# Autodesk Inventor assembly: Ensemble1
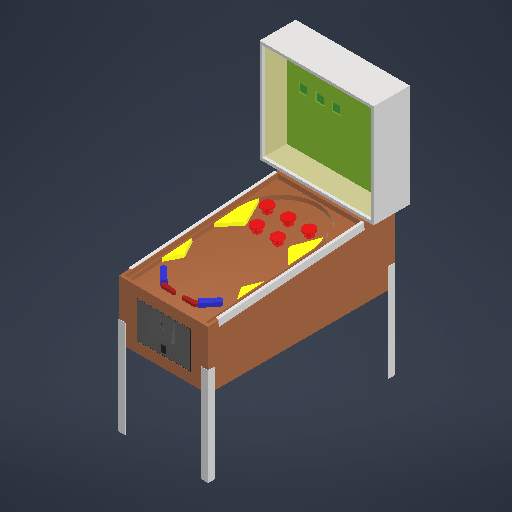
[picture p0: Inventor's stored thumbnail of the model, 512x512]
Saved by Autodesk Inventor 2027 (Build 310192060, 192F)
## iProperties
RuleStatus: InUse
Created: 2026-10-17
Part Number: Ensemble1
Document SubType Name: Assembly
Designer: strei
Author: strei
## Documents named in this file (12)
- C:\GIT\Ludum Dare 60\Assets\Models 3D\Pinball.iam
- C:\GIT\Ludum Dare 60\Assets\Models 3D\Front.ipt
- C:\GIT\Ludum Dare 60\Assets\Models 3D\Glass.ipt
- C:\GIT\Ludum Dare 60\Assets\Models 3D\Playfield.ipt
- C:\GIT\Ludum Dare 60\Assets\Models 3D\Box.ipt
- C:\GIT\Ludum Dare 60\Assets\Models 3D\Foot.ipt
- C:\GIT\Ludum Dare 60\Assets\Models 3D\Flipper.ipt
- C:\GIT\Ludum Dare 60\Assets\Models 3D\Electronic playfield.ipt
- C:\GIT\Ludum Dare 60\Assets\Models 3D\Electronic front.ipt
- C:\GIT\Ludum Dare 60\Assets\Models 3D\Bumper.ipt
- C:\GIT\Ludum Dare 60\Assets\Models 3D\side_bar.ipt
- C:\GIT\Ludum Dare 60\Assets\Models 3D\side_bumper.ipt
## Components (21 placed, 11 different names)
1. Front:1 — Placage:3, Placage:4, Affleurement:2, Placage:5, Affleurement:3, Affleurement:4, Placage:28, Placage:29, Placage:30
2. Glass:1 — Placage:3, Placage:4, Affleurement:2
3. Playfield:1 — Placage:1, Placage:2, Affleurement:1, Placage:21, Placage:22, Placage:23, Placage:24, Placage:31, Placage:32, Placage:33, Placage:34, Placage:35, Placage:36, Placage:37, Placage:38, Placage:39, Placage:40, Placage:47, Placage:48, Placage:49, Placage:51
4. Box:1 — Placage:1, Placage:2, Affleurement:1, Placage:5, Affleurement:3, Affleurement:4, Placage:6, Placage:7, Placage:8, Placage:11, Placage:12, Placage:13, Placage:14, Placage:15, Placage:16, Placage:17, Placage:18, Placage:19, Affleurement:5, Affleurement:6, Placage:25, Placage:26, Placage:27, Placage:41, Placage:42, Placage:43, Placage:44, Placage:45, Placage:46
5. Foot:1 — Placage:6, Placage:13, Placage:19, Placage:20
6. Foot:2 — Placage:7, Placage:8, Placage:14
7. Foot:3 — Placage:16, Placage:17, Placage:18
8. Foot:4 — Placage:11, Placage:12, Placage:15
9. Flipper:1 — Placage:21, Placage:23, Affleurement:7, Placage:50
10. Flipper:2 — Placage:22, Placage:24, Affleurement:7, Placage:52
11. Electronic playfield:1 — Placage:25, Placage:26, Placage:27
12. Electronic front:1 — Placage:28, Placage:29, Placage:30
13. Bumper:1 — Placage:34, Placage:39
14. Bumper:2 — Placage:35, Placage:38
15. Bumper:3 — Placage:32, Placage:36
16. Bumper:4 — Placage:33, Placage:37
17. Bumper:5 — Placage:31, Placage:40
18. side_bar:1 — Placage:41, Placage:42, Placage:45
19. side_bar:2 — Placage:43, Placage:44, Placage:46
20. side_bumper:1 — Placage:47, Placage:49, Placage:50
21. side_bumper:2 — Placage:48, Placage:51, Placage:52
## Relationships (57: Mate 50, Flush 7)
- Placage:1 [Mate]: Playfield:1 ↔ Box:1
- Placage:2 [Mate]: Playfield:1 ↔ Box:1
- Affleurement:1 [Flush] (60 mm): Playfield:1 ↔ Box:1
- Placage:3 [Mate]: Front:1 ↔ Glass:1
- Placage:4 [Mate]: Front:1 ↔ Glass:1
- Affleurement:2 [Flush] (20 mm): Front:1 ↔ Glass:1
- Placage:5 [Mate]: Front:1 ↔ Box:1
- Affleurement:3 [Flush] (-20 mm): Front:1 ↔ Box:1
- Affleurement:4 [Flush] (90 mm): Front:1 ↔ Box:1
- Placage:6 [Mate]: Box:1 ↔ Foot:1
- Placage:7 [Mate]: Box:1 ↔ Foot:2
- Placage:8 [Mate]: Box:1 ↔ Foot:2
- Placage:11 [Mate]: Box:1 ↔ Foot:4
- Placage:12 [Mate]: Box:1 ↔ Foot:4
- Placage:13 [Mate] (-150 mm): Box:1 ↔ Foot:1
- Placage:14 [Mate] (-150 mm): Box:1 ↔ Foot:2
- Placage:15 [Mate] (-150 mm): Box:1 ↔ Foot:4
- Placage:16 [Mate]: Box:1 ↔ Foot:3
- Placage:17 [Mate]: Box:1 ↔ Foot:3
- Placage:18 [Mate] (-150 mm): Box:1 ↔ Foot:3
- Placage:19 [Mate]: Box:1 ↔ Foot:1
- Placage:20 [Mate]: Foot:1
- Affleurement:5 [Flush]: Box:1
- Affleurement:6 [Flush] (-300 mm): Box:1
- Placage:21 [Mate]: Playfield:1 ↔ Flipper:1
- Placage:22 [Mate]: Playfield:1 ↔ Flipper:2
- Placage:23 [Mate]: Playfield:1 ↔ Flipper:1
- Placage:24 [Mate]: Playfield:1 ↔ Flipper:2
- Affleurement:7 [Flush]: Flipper:1 ↔ Flipper:2
- Placage:25 [Mate] (5 mm): Box:1 ↔ Electronic playfield:1
- Placage:26 [Mate] (5 mm): Box:1 ↔ Electronic playfield:1
- Placage:27 [Mate] (50 mm): Box:1 ↔ Electronic playfield:1
- Placage:28 [Mate] (5 mm): Front:1 ↔ Electronic front:1
- Placage:29 [Mate] (5 mm): Front:1 ↔ Electronic front:1
- Placage:30 [Mate] (50 mm): Front:1 ↔ Electronic front:1
- Placage:31 [Mate]: Playfield:1 ↔ Bumper:5
- Placage:32 [Mate]: Playfield:1 ↔ Bumper:3
- Placage:33 [Mate]: Playfield:1 ↔ Bumper:4
- Placage:34 [Mate]: Playfield:1 ↔ Bumper:1
- Placage:35 [Mate]: Playfield:1 ↔ Bumper:2
- Placage:36 [Mate] (5 mm): Playfield:1 ↔ Bumper:3
- Placage:37 [Mate] (5 mm): Playfield:1 ↔ Bumper:4
- Placage:38 [Mate] (5 mm): Playfield:1 ↔ Bumper:2
- Placage:39 [Mate] (5 mm): Playfield:1 ↔ Bumper:1
- Placage:40 [Mate] (5 mm): Playfield:1 ↔ Bumper:5
- Placage:41 [Mate]: Box:1 ↔ side_bar:1
- Placage:42 [Mate] (5 mm): Box:1 ↔ side_bar:1
- Placage:43 [Mate]: Box:1 ↔ side_bar:2
- Placage:44 [Mate] (5 mm): Box:1 ↔ side_bar:2
- Placage:45 [Mate]: Box:1 ↔ side_bar:1
- Placage:46 [Mate]: Box:1 ↔ side_bar:2
- Placage:47 [Mate]: Playfield:1 ↔ side_bumper:1
- Placage:48 [Mate]: Playfield:1 ↔ side_bumper:2
- Placage:49 [Mate]: Playfield:1 ↔ side_bumper:1
- Placage:50 [Mate]: Flipper:1 ↔ side_bumper:1
- Placage:51 [Mate]: Playfield:1 ↔ side_bumper:2
- Placage:52 [Mate]: Flipper:2 ↔ side_bumper:2
